# Autodesk Inventor assembly: 1111 FP-555x1500x47
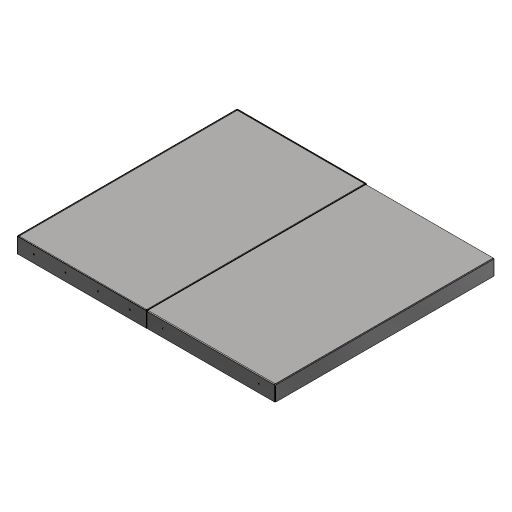
[picture p0: Inventor's stored thumbnail of the model, 512x512]
Saved by Autodesk Inventor 2024.3 (Build 283343000, 343)
## iProperties
Created: 2019-07-02
Part Number: 1111 FP-555x1500x47
Material: Generisch
Document SubType Name: Assembly
Designer: MK
Mass: 8083.61 g
Surface Area: 20671.5 cm^2
Volume: 1029.76 cm^3
Density: 7.85 g/cm^3
Description: Festes-Paneel
Author: MK
## Documents named in this file (3)
- C:\Users\la\Documents\GitHub\Inventor_Sizer\C# Version\masters\FP\2T\1111 FP-555x1500x47.iam
- C:\Users\la\Documents\GitHub\Inventor_Sizer\C# Version\masters\FP\2T\1111 555x1500x47-Au.ipt
- C:\Users\la\Documents\GitHub\Inventor_Sizer\C# Version\masters\FP\2T\1111 555x1500x47-In-2T.ipt
## Components (3 placed, 2 different names)
1. 1111 555x1500x47-Au:1 — Passend:1, Fluchtend:1, Passend:2
2. 1111 555x1500x47-In-2T:1 — Passend:1, Fluchtend:1, Passend:2, Fluchtend:2, Passend:3, Fluchtend:3
3. 1111 555x1500x47-In-2T:2 — Fluchtend:2, Passend:3, Fluchtend:3
## Relationships (6: Mate 3, Flush 3)
- Passend:1 [Mate] (0.5 mm): 1111 555x1500x47-Au:1 ↔ 1111 555x1500x47-In-2T:1
- Fluchtend:1 [Flush]: 1111 555x1500x47-Au:1 ↔ 1111 555x1500x47-In-2T:1
- Passend:2 [Mate] (0.5 mm): 1111 555x1500x47-Au:1 ↔ 1111 555x1500x47-In-2T:1
- Fluchtend:2 [Flush]: 1111 555x1500x47-In-2T:1 ↔ 1111 555x1500x47-In-2T:2
- Passend:3 [Mate]: 1111 555x1500x47-In-2T:1 ↔ 1111 555x1500x47-In-2T:2
- Fluchtend:3 [Flush]: 1111 555x1500x47-In-2T:1 ↔ 1111 555x1500x47-In-2T:2
## Named parameters: Clearance = 0.5 mm
